# Autodesk Inventor assembly: 3842538683
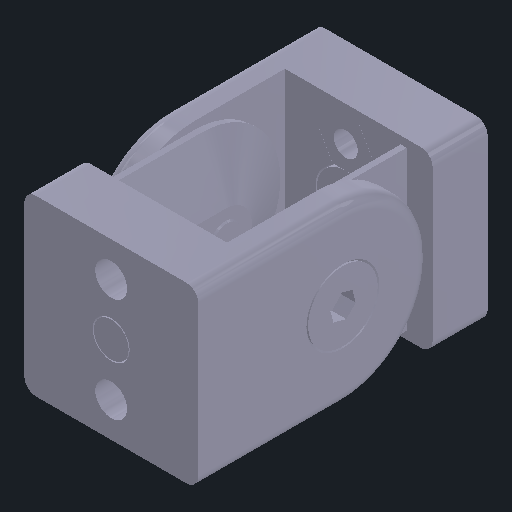
[picture p0: Inventor's stored thumbnail of the model, 512x512]
Saved by Autodesk Inventor 2026 (Build 300175050, 175E)
## iProperties
Created: 2026-09
Part Number: 3842538683
Document SubType Name: Assembly
Designer: Anura
Catalog Web Link: www.boschrexroth.com/brl
Description: Joint 30x30
Vendor: Bosch Rexroth AG - BRL
Package size: 1
Material no.: 3842538683.0
Part name: Joint 30x30
Parameters: N8
Weight: 0.195
Product group: MGE
HS code: 76169910.0
Format Version: 0
MTproCodeNo: 76169910.0
MTproDesignation: Joint 30x30
MtproPline: 20
MTproPrice: 0.0
MTproWeight: 0.195
MtproWeightUnit: kg
Major Version: 4
Minor Version: 0
OrderNo: 3842538683.0
Param: N8
ProductId: Bosch Rexroth AG
Sending System: Bosch Rexroth AG
JointProfileLength: 200
DistanceFromCenter_3842538683_Joint30x30_150_260915130804560: 0,000 mm
ProfileRotationAngle_3842538683_Joint30x30_150_2609151308045: 0,00 deg
Accessories: Not selected
Author: Anura
## Documents named in this file (4)
- C:\Uni\Bachelorarbeit\CAD\Final Design v2\3842538683_Joint 30x30_150_260915130804560.iam
- C:\Uni\Bachelorarbeit\CAD\Final Design v2\3842538683_Joint 30x30_150_260915130804560_1.ipt
- C:\Uni\Bachelorarbeit\CAD\Final Design v2\3842538683_Joint 30x30_150_260915130804560_2.ipt
- C:\Uni\Bachelorarbeit\CAD\Final Design v2\3842993703_STRUT PROFILE 30x30_h150_260915130435922.ipt
## Components (2 placed, 2 different names)
1. 3842538683_Joint 30x30_150_260915130804560_1:1 — BR_Constraint_Mate__1_3, BR_Constraint_Mate__2_5, BR_Constraint_Angle__2_6
2. 3842538683_Joint 30x30_150_260915130804560_2:1 — BR_Constraint_Mate__1_1, BR_Constraint_Flush__1_2, BR_Constraint_Mate__1_3, BR_Constraint_Angle__2_6, BR_Constraint_Mate__2_4
## Relationships (6: Mate 4, Flush 1, Angle 1)
- BR_Constraint_Mate__1_1 [Mate]: 3842538683_Joint 30x30_150_260915130804560_2:1
- BR_Constraint_Flush__1_2 [Flush]: 3842538683_Joint 30x30_150_260915130804560_2:1
- BR_Constraint_Mate__1_3 [Mate]: 3842538683_Joint 30x30_150_260915130804560_1:1 ↔ 3842538683_Joint 30x30_150_260915130804560_2:1
- BR_Constraint_Mate__2_5 [Mate]: 3842538683_Joint 30x30_150_260915130804560_1:1
- BR_Constraint_Angle__2_6 [Angle] (0 deg): 3842538683_Joint 30x30_150_260915130804560_1:1 ↔ 3842538683_Joint 30x30_150_260915130804560_2:1
- BR_Constraint_Mate__2_4 [Mate]: 3842538683_Joint 30x30_150_260915130804560_2:1
## Named parameters: BR_Angle = 0 deg, BR_WP33_BR_WP10_Length_095612221547926 = 300 mm
